# Autodesk Inventor assembly: 3축직교로봇 및 그리퍼
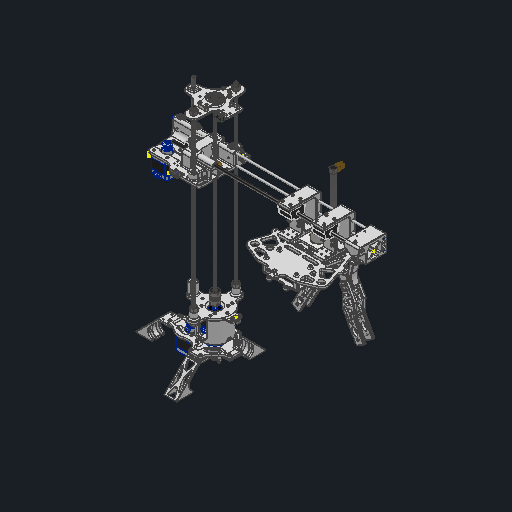
[picture p0: Inventor's stored thumbnail of the model, 512x512]
Saved by Autodesk Inventor 2026.3 (Build 303398000, 398)
## iProperties
Created: 2026-03-18
Part Number: 3축직교로봇 및 그리퍼
Document SubType Name: Assembly
Designer: work
Author: work
## Documents named in this file (6)
- C:\Users\khw\Desktop\ARD_v1\3축직교로봇 및 그리퍼.iam
- C:\Users\khw\Desktop\ARD_v1\ARD_hardware\RA_Project\RA_v1.iam
- C:\Users\khw\Desktop\ARD_v1\ARD_hardware\ARD_Model_v1\2B_set\AIP\FEA\fdflh83ds.fins
- C:\Users\khw\Desktop\ARD_v1\ARD_hardware\ARD_Model_v1\2B_set\AIP\FEA\fdflh83ds.fsat
- C:\Users\khw\Desktop\ARD_v1\ARD_hardware\ARD_Model_v1\2B_set\AIP\FEA\fdflh83ds.ftes
- C:\Users\khw\Desktop\ARD_v1\ARD_hardware\ARD_Model_v1\2B_set\AIP\FEA\fdflh83ds.fwiz
## Components (1 placed, 1 different names)
1. RA_v1:1 [sub-assembly]
## Named parameters: sa_0 = 10000
note: some values were not read from the file. Shown as the stored number, unit unknown: "sa_0".
